# Autodesk Inventor assembly: Airplane
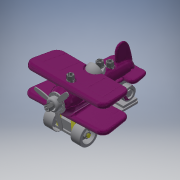
[picture p0: Inventor's stored thumbnail of the model, 180x180]
Saved by Autodesk Inventor 2017 (Build 210142000, 142)
## iProperties
Created: 2017-08-21
Part Number: Airplane
Document SubType Name: Assembly
Designer: MineV
Author: MineV
## Documents named in this file (14)
- C:\Users\minea\Documents\Vault\vault\Airplane.iam
- C:\Users\minea\Documents\Vault\vault\Plane_horizontal_holder.ipt
- C:\Users\minea\Documents\Vault\vault\Imported Components\rear_mesh\rear_mesh.ipt
- C:\Users\minea\Documents\GitHub\assembly_models\battat\Imported Components\UnderBody\UnderBody.ipt
- C:\Users\minea\Documents\GitHub\assembly_models\battat\Imported Components\UpperBody\UpperBody.ipt
- C:\Users\minea\Documents\Vault\vault\Nut.ipt
- C:\Users\minea\Documents\Vault\vault\FrontWheel.ipt
- C:\Users\minea\Documents\Vault\vault\MotorGrill.ipt
- C:\Users\minea\Documents\Vault\vault\Propeller.ipt
- C:\Users\minea\Documents\Vault\vault\Imported Components\chassis\chassis.ipt
- C:\Users\minea\Documents\GitHub\assembly_models\battat\plane\Imported Components\BottomWing\BottomWing.ipt
- C:\Users\minea\Documents\GitHub\assembly_models\battat\plane\Imported Components\TopWing\TopWing.ipt
- C:\Users\minea\Documents\Vault\vault\Imported Components\rear_mesh\Bolt.ipt
- C:\Users\minea\Documents\Vault\vault\Window.ipt
## Components (18 placed, 13 different names)
1. Plane_horizontal_holder:1 — Mate:1, Mate:2, Mate:3, Mate:14, Flush:1, Mate:16, Mate:17, Mate:22, Mate:23, Mate:24
2. rear_mesh:1 — Flush:1, Mate:16, Mate:17
3. UnderBody:1
4. UpperBody:1
5. Nut:1 — Mate:10, Mate:11
6. Nut:2 — Mate:12, Mate:13
7. FrontWheel:1 — Mate:6, Mate:7
8. FrontWheel:2 — Mate:4, Mate:5
9. MotorGrill:1 — Mate:8, Mate:9
10. Propeller:1 — Mate:8, Mate:9, Mate:25, Mate:26
11. chassis:1 — Mate:1, Mate:2, Mate:3, Mate:4, Mate:5, Mate:6, Mate:7, Mate:10, Mate:11, Mate:12, Mate:13, Mate:18, Mate:21, Flush:2
12. BottomWing:1 — Mate:18
13. TopWing:1
14. Bolt:1 — Mate:21, Flush:2
15. Bolt:2 — Mate:22, Mate:23
16. Bolt:3 — Mate:19, Mate:20
17. Window:1 — Mate:19, Mate:20, Mate:24
18. Bolt:4 — Mate:25, Mate:26
## Relationships (27: Mate 25, Flush 2)
- Mate:1: Plane_horizontal_holder:1 ↔ chassis:1
- Mate:2: Plane_horizontal_holder:1 ↔ chassis:1
- Mate:3: Plane_horizontal_holder:1 ↔ chassis:1
- Mate:4: FrontWheel:2 ↔ chassis:1
- Mate:5: FrontWheel:2 ↔ chassis:1
- Mate:6: FrontWheel:1 ↔ chassis:1
- Mate:7: FrontWheel:1 ↔ chassis:1
- Mate:8: MotorGrill:1 ↔ Propeller:1
- Mate:9: MotorGrill:1 ↔ Propeller:1
- Mate:10: Nut:1 ↔ chassis:1
- Mate:11: Nut:1 ↔ chassis:1
- Mate:12: Nut:2 ↔ chassis:1
- Mate:13: Nut:2 ↔ chassis:1
- Mate:14: Plane_horizontal_holder:1
- Flush:1: Plane_horizontal_holder:1 ↔ rear_mesh:1
- Mate:16: Plane_horizontal_holder:1 ↔ rear_mesh:1
- Mate:17: Plane_horizontal_holder:1 ↔ rear_mesh:1
- Mate:18: chassis:1 ↔ BottomWing:1
- Mate:19: Bolt:3 ↔ Window:1
- Mate:20 (15 mm): Bolt:3 ↔ Window:1
- Mate:21: chassis:1 ↔ Bolt:1
- Flush:2 (55 mm): chassis:1 ↔ Bolt:1
- Mate:22: Plane_horizontal_holder:1 ↔ Bolt:2
- Mate:23 (110 mm): Plane_horizontal_holder:1 ↔ Bolt:2
- Mate:24 (112 mm): Plane_horizontal_holder:1 ↔ Window:1
- Mate:25: Propeller:1 ↔ Bolt:4
- Mate:26 (15 mm): Propeller:1 ↔ Bolt:4
